# Autodesk Inventor assembly: ansamblu_corect
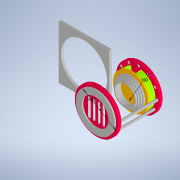
[picture p0: Inventor's stored thumbnail of the model, 180x180]
Saved by Autodesk Inventor 2022.6 (Build 266554000, 554)
## iProperties
Created: 2025-06-12
Part Number: ansamblu_corect
Document SubType Name: Assembly
Designer: Dragos Macovei
Author: Dragos Macovei
## Documents named in this file (17)
- C:\Users\Dragos Macovei\Documents\Inventor_3d_parts\Felinar\Felinar_4\ansamblu_corect.iam
- C:\Users\Dragos Macovei\Documents\Inventor_3d_parts\Felinar\capac_felinar_gaurit.ipt
- C:\Users\Dragos Macovei\Documents\Inventor_3d_parts\Felinar\CAPAC_FELINAR_NR_4.ipt
- C:\Users\Dragos Macovei\Documents\Inventor_3d_parts\Felinar\suport_lumanare_2.ipt
- C:\Users\Dragos Macovei\Documents\Inventor_3d_parts\Felinar\suport_lumanare_3.ipt
- C:\Users\Dragos Macovei\Documents\Inventor_3d_parts\Felinar\suport_lumanare_4.ipt
- C:\Users\Dragos Macovei\Documents\Inventor_3d_parts\Felinar\suport_lumanare_5.ipt
- C:\Users\Dragos Macovei\Documents\Inventor_3d_parts\Felinar\capac felinar_b.ipt
- inel_decorativ_capac.ipt
- C:\Users\Dragos Macovei\Documents\Inventor_3d_parts\Felinar\capac_baterie.ipt
- C:\Users\Dragos Macovei\Documents\Inventor_3d_parts\Felinar\cover_rfid.ipt
- C:\Users\Dragos Macovei\Documents\Inventor_3d_parts\Felinar\fund felinar.ipt
- C:\Users\Dragos Macovei\Documents\Inventor_3d_parts\Felinar\fund felinar_gaurit.ipt
- C:\Users\Dragos Macovei\Documents\Inventor_3d_parts\Felinar\inglobare_baterie.ipt
- C:\Users\Dragos Macovei\Documents\Inventor_3d_parts\Felinar\Suport_felinar_general.ipt
- C:\Users\Dragos Macovei\Documents\Inventor_3d_parts\Felinar\cep.ipt
- C:\Users\Dragos Macovei\Documents\Inventor_3d_parts\Felinar\inglobare_baterie_cu_decupaj_buton.ipt
## Components (18 placed, 15 different names)
1. capac_felinar_gaurit:1 — Insert:3, Insert:4, Mate:1, Mate:2, Mate:4
2. CAPAC_FELINAR_NR_4:1 — Mate:1, Mate:2, Mate:3
3. suport_lumanare_2:1 — Mate:5, Mate:8, Mate:16
4. suport_lumanare_3:1 — Mate:5, Mate:6, Mate:8, Mate:9, Mate:17
5. suport_lumanare_4:1 — Mate:6, Mate:7, Mate:9, Mate:10
6. suport_lumanare_5:1 — Mate:7, Mate:10
7. inel_decorativ_capac:1 — Mate:3, Mate:4
8. capac_baterie:1 — Mate:14, Mate:15, Mate:16, Mate:17
9. cover_rfid:1 — Mate:22, Mate:23
10. fund felinar:1 — Mate:19, Mate:20, Mate:22, Mate:23
11. fund felinar_gaurit:1 — Insert:1, Insert:2, Mate:18, Mate:19, Mate:20, Mate:21
12. inglobare_baterie:1 — Flush:6, Mate:18, Mate:21, Mate:24, Flush:7, Mate:25
13. Suport_felinar_general:1
14. cep:1 — Insert:2, Insert:4
15. cep:2 — Insert:1, Insert:3
16. inglobare_baterie:3 — Mate:13, Flush:4, Flush:5, Mate:26, Mate:27
17. inglobare_baterie:4 — Mate:13, Flush:4, Flush:5, Flush:6, Mate:14, Mate:15
18. inglobare_baterie_cu_decupaj_buton:1 — Mate:24, Flush:7, Mate:25, Mate:26, Mate:27
## Relationships (33: Mate 25, Insert 4, Flush 4)
- Insert:1 (-6 mm): fund felinar_gaurit:1 ↔ cep:2
- Insert:2: fund felinar_gaurit:1 ↔ cep:1
- Insert:3: capac_felinar_gaurit:1 ↔ cep:2
- Insert:4: capac_felinar_gaurit:1 ↔ cep:1
- Mate:1: capac_felinar_gaurit:1 ↔ CAPAC_FELINAR_NR_4:1
- Mate:2: capac_felinar_gaurit:1 ↔ CAPAC_FELINAR_NR_4:1
- Mate:3: CAPAC_FELINAR_NR_4:1 ↔ inel_decorativ_capac:1
- Mate:4: capac_felinar_gaurit:1 ↔ inel_decorativ_capac:1
- Mate:5: suport_lumanare_2:1 ↔ suport_lumanare_3:1
- Mate:6: suport_lumanare_3:1 ↔ suport_lumanare_4:1
- Mate:7: suport_lumanare_4:1 ↔ suport_lumanare_5:1
- Mate:8: suport_lumanare_2:1 ↔ suport_lumanare_3:1
- Mate:9: suport_lumanare_3:1 ↔ suport_lumanare_4:1
- Mate:10: suport_lumanare_4:1 ↔ suport_lumanare_5:1
- Mate:13: inglobare_baterie:3 ↔ inglobare_baterie:4
- Flush:4: inglobare_baterie:3 ↔ inglobare_baterie:4
- Flush:5: inglobare_baterie:3 ↔ inglobare_baterie:4
- Flush:6: inglobare_baterie:1 ↔ inglobare_baterie:4
- Mate:14: capac_baterie:1 ↔ inglobare_baterie:4
- Mate:15: capac_baterie:1 ↔ inglobare_baterie:4
- Mate:16: suport_lumanare_2:1 ↔ capac_baterie:1
- Mate:17: suport_lumanare_3:1 ↔ capac_baterie:1
- Mate:18: fund felinar_gaurit:1 ↔ inglobare_baterie:1
- Mate:19: fund felinar:1 ↔ fund felinar_gaurit:1
- Mate:20: fund felinar:1 ↔ fund felinar_gaurit:1
- Mate:21: fund felinar_gaurit:1 ↔ inglobare_baterie:1
- Mate:22: cover_rfid:1 ↔ fund felinar:1
- Mate:23: cover_rfid:1 ↔ fund felinar:1
- Mate:24: inglobare_baterie:1 ↔ inglobare_baterie_cu_decupaj_buton:1
- Flush:7: inglobare_baterie:1 ↔ inglobare_baterie_cu_decupaj_buton:1
- Mate:25: inglobare_baterie:1 ↔ inglobare_baterie_cu_decupaj_buton:1
- Mate:26: inglobare_baterie:3 ↔ inglobare_baterie_cu_decupaj_buton:1
- Mate:27: inglobare_baterie:3 ↔ inglobare_baterie_cu_decupaj_buton:1
